# Autodesk Inventor assembly: asm_moteur_roue
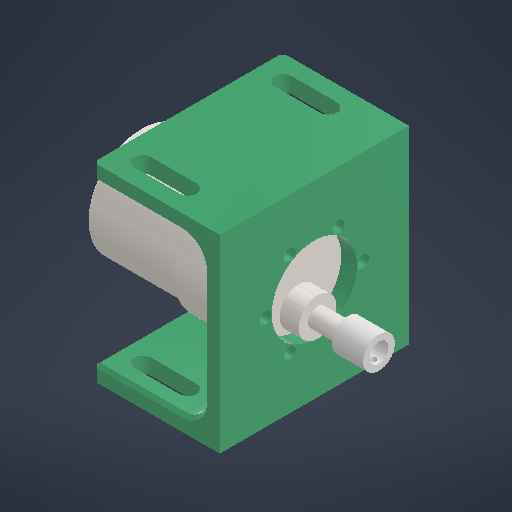
[picture p0: Inventor's stored thumbnail of the model, 512x512]
Saved by Autodesk Inventor 2026 (Build 300175050, 175E)
## iProperties
Created: 2025-05-15
Part Number: asm_moteur_roue
Document SubType Name: Assembly
Designer: remg9
Author: remg9
## Documents named in this file (4)
- C:\Users\karle\OneDrive - HESSO\P2511_Dossier_partage_RVEZ\01_Robot\0101_CAO\Moteur\asm_moteur_roue.iam
- C:\Users\karle\OneDrive - HESSO\P2511_Dossier_partage_RVEZ\01_Robot\0101_CAO\Moteur\Support moteur double.ipt
- C:\Users\karle\OneDrive - HESSO\P2511_Dossier_partage_RVEZ\01_Robot\0101_CAO\Moteur\modelcraftrb3500300001\modelcraftrb3500300001\modelcraftrb3500300001.ipt
- C:\Users\karle\OneDrive - HESSO\P2511_Dossier_partage_RVEZ\01_Robot\0101_CAO\Moteur\bride arbre moteur.ipt
## Components (3 placed, 3 different names)
1. Support moteur double:1 — Einfügen:4, Einfügen:5
2. modelcraftrb3500300001:1 — Einfügen:4, Einfügen:5, Einfügen:6
3. bride arbre moteur:1 — Einfügen:6
## Relationships (3: Insert 3)
- Einfügen:4 [Insert]: Support moteur double:1 ↔ modelcraftrb3500300001:1
- Einfügen:5 [Insert]: Support moteur double:1 ↔ modelcraftrb3500300001:1
- Einfügen:6 [Insert] (-5 mm): modelcraftrb3500300001:1 ↔ bride arbre moteur:1
